# Autodesk Inventor assembly: ASSEMBLY_HTD3M_Idler_A_Axis
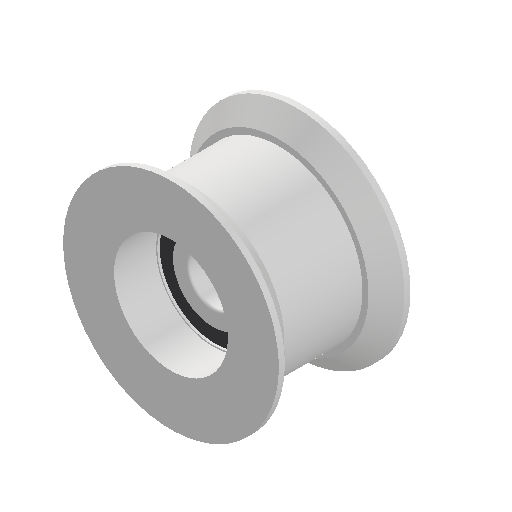
[picture p0: Inventor's stored thumbnail of the model, 512x512]
Saved by Autodesk Inventor 2027 (Build 310192060, 192F)
## iProperties
Created: 2026-01-06
Part Number: ASSEMBLY_HTD3M_Idler_A_Axis
Document SubType Name: Assembly
Designer: User
Author: User
## Documents named in this file (5)
- C:\Users\lacze\OneDrive\_DRIVE_SYNCH_FILES\RF - Antenna Positioner\MCAD\1_V1\ASSEMBLY_DUT_ANT_POSITIONER_REVA\ASSEMBLY_HTD3M_Idler_A_Axis.iam
- C:\Users\lacze\OneDrive\_DRIVE_SYNCH_FILES\RF - Antenna Positioner\MCAD\1_V1\ASSEMBLY_DUT_ANT_POSITIONER_REVA\3DP_PLA_HTD3M_6mm_Belt_Idler.ipt
- C:\Users\lacze\OneDrive\_DRIVE_SYNCH_FILES\RF - Antenna Positioner\MCAD\1_V1\__COTS_PARTS\COTS_GENERIC_604H_2RS_4x12x4mm_Ball_Bearing\COTS_GENERIC_604H_2RS_4x12x4mm_Ball_Bearing.ipt
- C:\Users\lacze\OneDrive\_DRIVE_SYNCH_FILES\RF - Antenna Positioner\MCAD\1_V1\ASSEMBLY_DUT_ANT_POSITIONER_REVA\3DP_PLA_HTD3M_6mm_Belt_Idler_Top_Cover.ipt
- C:\Users\lacze\OneDrive\_DRIVE_SYNCH_FILES\RF - Antenna Positioner\MCAD\1_V1\ASSEMBLY_DUT_ANT_POSITIONER_REVA\3DP_PLA_HTD3M_6mm_Belt_Idler_Bottom_Washer.ipt
## Components (4 placed, 4 different names)
1. 3DP_PLA_HTD3M_6mm_Belt_Idler:1 — Mate:2, Mate:3, Mate:4, Mate:7, Mate:8
2. COTS_GENERIC_604H_2RS_4x12x4mm_Ball_Bearing:1 — Mate:2, Mate:5, Mate:6, Mate:7
3. 3DP_PLA_HTD3M_6mm_Belt_Idler_Top_Cover:1 — Mate:3, Mate:4
4. 3DP_PLA_HTD3M_6mm_Belt_Idler_Bottom_Washer:1 — Mate:5, Mate:6
## Relationships (7: Mate 7)
- Mate:2: 3DP_PLA_HTD3M_6mm_Belt_Idler:1 ↔ COTS_GENERIC_604H_2RS_4x12x4mm_Ball_Bearing:1
- Mate:3: 3DP_PLA_HTD3M_6mm_Belt_Idler:1 ↔ 3DP_PLA_HTD3M_6mm_Belt_Idler_Top_Cover:1
- Mate:4: 3DP_PLA_HTD3M_6mm_Belt_Idler:1 ↔ 3DP_PLA_HTD3M_6mm_Belt_Idler_Top_Cover:1
- Mate:5: COTS_GENERIC_604H_2RS_4x12x4mm_Ball_Bearing:1 ↔ 3DP_PLA_HTD3M_6mm_Belt_Idler_Bottom_Washer:1
- Mate:6: COTS_GENERIC_604H_2RS_4x12x4mm_Ball_Bearing:1 ↔ 3DP_PLA_HTD3M_6mm_Belt_Idler_Bottom_Washer:1
- Mate:7: 3DP_PLA_HTD3M_6mm_Belt_Idler:1 ↔ COTS_GENERIC_604H_2RS_4x12x4mm_Ball_Bearing:1
- Mate:8: 3DP_PLA_HTD3M_6mm_Belt_Idler:1
